# Autodesk Inventor assembly: zjednodušený
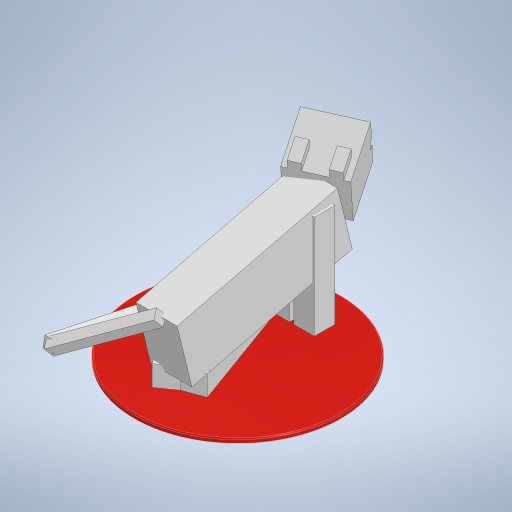
[picture p0: Inventor's stored thumbnail of the model, 512x512]
Saved by Autodesk Inventor 2024 (Build 280153000, 153)
## iProperties
Created: 2025-11-11
Part Number: zjednodušený
Document SubType Name: Assembly
Designer: zak
Author: zak
## Documents named in this file (6)
- D:\Podpleský\zjednodušený.iam
- D:\Podpleský\Podstava.ipt
- D:\Podpleský\tělo.ipt
- D:\Podpleský\hlava.ipt
- D:\Podpleský\noha.ipt
- D:\Podpleský\část ocasu.ipt
## Components (9 placed, 5 different names)
1. Podstava:1 — Stejný směr:1, Stejný směr:2, Stejný směr:3, Proti sobě:1, Proti sobě:4, Proti sobě:6, Proti sobě:7, Proti sobě:8, Proti sobě:10, Úhel:7
2. tělo:1 — Proti sobě:2, Úhel:1, Úhel:2, Proti sobě:3, Proti sobě:5, Úhel:4, Úhel:5, Úhel:6
3. hlava:1 — Úhel:1, Úhel:2
4. noha:1 — Proti sobě:3, Proti sobě:4, Stejný směr:4
5. noha:2 — Proti sobě:5, Proti sobě:6, Stejný směr:4
6. noha:3 — Proti sobě:7, Úhel:3, Proti sobě:9
7. noha:4 — Proti sobě:8, Úhel:3, Proti sobě:9, Úhel:4
8. část ocasu:1 — Úhel:5, Úhel:6
9. část ocasu:2 — Proti sobě:10, Úhel:7
## Relationships (21: Mate 10, Angle 7, Flush 4)
- Stejný směr:1 [Flush]: Podstava:1
- Stejný směr:2 [Flush]: Podstava:1
- Stejný směr:3 [Flush]: Podstava:1
- Proti sobě:1 [Mate]: Podstava:1
- Proti sobě:2 [Mate]: tělo:1
- Úhel:1 [Angle] (100 deg): tělo:1 ↔ hlava:1
- Úhel:2 [Angle] (30 deg): tělo:1 ↔ hlava:1
- Proti sobě:3 [Mate] (1 mm): tělo:1 ↔ noha:1
- Proti sobě:4 [Mate]: Podstava:1 ↔ noha:1
- Proti sobě:5 [Mate] (1 mm): tělo:1 ↔ noha:2
- Proti sobě:6 [Mate]: Podstava:1 ↔ noha:2
- Stejný směr:4 [Flush]: noha:1 ↔ noha:2
- Proti sobě:7 [Mate]: Podstava:1 ↔ noha:3
- Proti sobě:8 [Mate]: Podstava:1 ↔ noha:4
- Úhel:3 [Angle] (15 deg): noha:3 ↔ noha:4
- Proti sobě:9 [Mate]: noha:3 ↔ noha:4
- Úhel:4 [Angle] (200 deg): tělo:1 ↔ noha:4
- Úhel:5 [Angle] (-30 deg): tělo:1 ↔ část ocasu:1
- Úhel:6 [Angle] (-60 deg): tělo:1 ↔ část ocasu:1
- Proti sobě:10 [Mate] (-1 mm): Podstava:1 ↔ část ocasu:2
- Úhel:7 [Angle] (-12 deg): Podstava:1 ↔ část ocasu:2
